# Autodesk Inventor assembly: MM0948AN002_G30_001
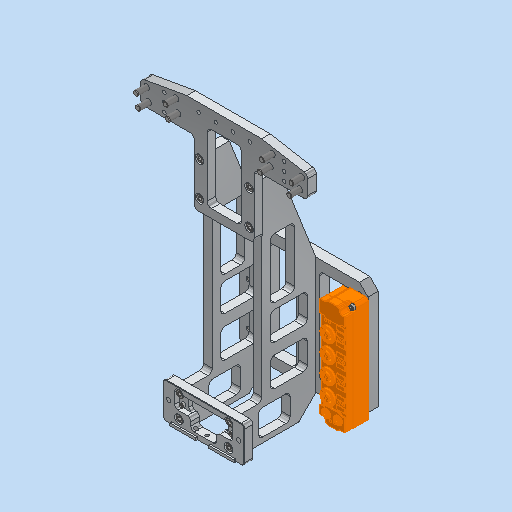
[picture p0: Inventor's stored thumbnail of the model, 512x512]
Saved by Autodesk Inventor 2023.3 (Build 273359000, 359)
## iProperties
RuleStatus: InUse
Created: 2023-03-23
Part Number: MM0948AN002_G30_001
Description: =<RBPARTNOTITLE2>
Document SubType Name: Assembly
Designer: FH/Wi
Mass: 1263.27 g
Surface Area: 1647.2 cm^2
Volume: 440.021 cm^3
Density: 2.87093 g/cm^3
AnP_Kategorie: 99
AnP_Material: =<Material>
AnP_TemplVers: 20200821
RBDOCUMENTTYPE: DRF
RBDOCUMENTVERSION: 00
RBDRAWINGMAINSCALE: 1:1
RBDRAWINGMISSINGSPEC: --
RBDRAWINGVOLUME: --
RBDSV1: 0850
RBGBEDGESIN1: +0,5
RBGBEDGESIN2: +0,2
RBGBEDGESOUT1: -0,3
RBGBEDGESOUT2: -0,1
RBMATERIAL: =<Material>
RBMATMEETS: --
RBMATNO: =<Part Number>
RBPARTMADEOF: --
RBPARTNO: SIEHE MNR
RBPARTNOTITLE1: mount ViscoDuo
RBPARTNOTITLE2: Halter ViscoDuo
RBPARTSAFETYINDICATOR: --
RBSURFACE: --
RBSURFACE2: --
RBZEDGESNORM: ISO13715:2002-06
RBZGENDIMCLASS: m
RBZGENDIMNORM: ISO 2768-1:1989-11
RBZGENGEOCLASS: H
RBZGENGEONORM: ISO 2768-2:1989-11
RBZSURFACENORM: ISO13D2:2002-02
RBZTOLERANCENORM: ISO 14405-1:2010-12
Author: FH/Wi
Keywords: =<RBPARTMADEOF>
Comments: =<RBSURFACE2>
Revision Number: 01
## Documents named in this file (13)
- C:\Users\rea9an\Documents\Inventor\TCAI2412_te1910_EM\AS00000929.iam
- C:\Users\rea9an\Documents\Inventor\TCAI2412_te1910_EM\PT00004887.ipt
- C:\Users\rea9an\Documents\Inventor\TCAI2412_te1910_EM\PT00004877.ipt
- C:\Users\rea9an\Documents\Inventor\TCAI2412_te1910_EM\PT00004924.ipt
- C:\Users\rea9an\Documents\Inventor\TCAI2412_te1910_EM\PT00004888.ipt
- C:\Users\rea9an\Documents\Inventor\TCAI2412_te1910_EM\PT00004879.ipt
- C:\Users\rea9an\Documents\Inventor\TCAI2412_te1910_EM\PT00004367.ipt
- C:\Users\rea9an\Documents\Inventor\TCAI2412_te1910_EM\PT00004859.ipt
- C:\Users\rea9an\Documents\Inventor\TCAI2412_te1910_EM\PT00004574.ipt
- C:\Users\rea9an\Documents\Inventor\TCAI2412_te1910_EM\PT00004578.ipt
- C:\Users\rea9an\Documents\Inventor\TCAI2412_te1910_EM\PT00004579.ipt
- C:\Users\rea9an\Documents\Inventor\TCAI2412_te1910_EM\PT00004907.ipt
- C:\Users\rea9an\Documents\Inventor\TCAI2412_te1910_EM\PT00004580.ipt
## Components (33 placed, 12 different names)
1. PT00004580:1 — Einfügen:58, Passend:17
2. PT00004574:1 — Passend:16, Passend:19, Passend:20
3. PT00004578:1 — Einfügen:51, Passend:15, Einfügen:58, Passend:16, Passend:17, Passend:20
4. PT00004579:1 — Passend:12, Passend:13, Einfügen:50, Passend:14, Einfügen:51, Passend:15, Einfügen:60, Passend:18
5. PT00004578:2 — Einfügen:50, Passend:14, Einfügen:57, Passend:19
6. PT00004877:6
7. PT00004877:7
8. PT00004877:9
9. PT00004877:8
10. PT00004907:1
11. PT00004907:2 — Einfügen:57
12. PT00004887:1
13. PT00004887:2
14. PT00004887:3
15. PT00004887:4
16. PT00004887:5
17. PT00004887:6
18. PT00004887:7
19. PT00004887:8
20. PT00004877:2
21. PT00004877:3
22. PT00004877:4
23. PT00004877:5
24. PT00004924:1
25. PT00004924:2
26. PT00004888:1 — Passend:13
27. PT00004888:2 — Passend:12
28. PT00004879:5
29. PT00004879:7
30. PT00004888:3
31. PT00004367:1 — Einfügen:60, Passend:18
32. PT00004859:1
33. PT00004859:2
## Relationships (33: Insert 24, Mate 9)
- [Insert]: PT00004580:1 ↔ PT00004887:4
- [Insert]: PT00004580:1 ↔ PT00004887:3
- [Insert]: PT00004580:1 ↔ PT00004887:2
- [Insert]: PT00004580:1 ↔ PT00004887:1
- [Insert]: PT00004580:1 ↔ PT00004887:8
- [Insert]: PT00004580:1 ↔ PT00004887:7
- [Insert]: PT00004580:1 ↔ PT00004887:6
- [Insert]: PT00004580:1 ↔ PT00004887:5
- [Insert]: PT00004580:1 ↔ PT00004877:2
- [Insert]: PT00004580:1 ↔ PT00004877:3
- [Insert]: PT00004580:1 ↔ PT00004877:4
- [Insert]: PT00004580:1 ↔ PT00004877:5
- [Insert]: PT00004367:1 ↔ PT00004859:2
- [Insert]: PT00004367:1 ↔ PT00004859:1
- Passend:12 [Mate]: PT00004579:1 ↔ PT00004888:2
- Passend:13 [Mate]: PT00004579:1 ↔ PT00004888:1
- Einfügen:50 [Insert]: PT00004579:1 ↔ PT00004578:2
- Passend:14 [Mate]: PT00004579:1 ↔ PT00004578:2
- Einfügen:51 [Insert]: PT00004578:1 ↔ PT00004579:1
- Passend:15 [Mate]: PT00004578:1 ↔ PT00004579:1
- [Insert]: PT00004574:1 ↔ PT00004877:6
- [Insert]: PT00004574:1 ↔ PT00004877:7
- [Insert]: PT00004574:1 ↔ PT00004877:9
- [Insert]: PT00004574:1 ↔ PT00004877:8
- [Insert]: PT00004578:1 ↔ PT00004907:1
- Einfügen:57 [Insert]: PT00004578:2 ↔ PT00004907:2
- Einfügen:58 [Insert]: PT00004580:1 ↔ PT00004578:1
- Passend:16 [Mate]: PT00004574:1 ↔ PT00004578:1
- Passend:17 [Mate]: PT00004580:1 ↔ PT00004578:1
- Einfügen:60 [Insert]: PT00004579:1 ↔ PT00004367:1
- Passend:18 [Mate]: PT00004579:1 ↔ PT00004367:1
- Passend:19 [Mate]: PT00004574:1 ↔ PT00004578:2
- Passend:20 [Mate]: PT00004574:1 ↔ PT00004578:1
## Named parameters: d343_d260 = 0 mm, d344_d261 = 0 mm
